# Autodesk Inventor assembly: 2026 Tiger Burn Head (UPDATED 2x4 TRUE) Model
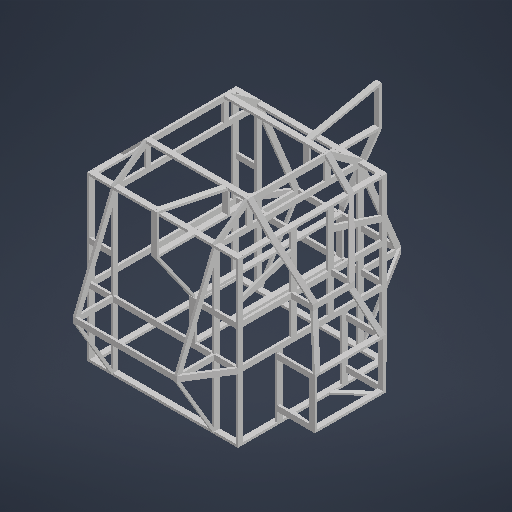
[picture p0: Inventor's stored thumbnail of the model, 512x512]
Saved by Autodesk Inventor 2027 (Build 310192000, 192)
## iProperties
Created: 2026-10-16
Part Number: 2026 Tiger Burn Head (UPDATED 2x4 TRUE) Model
Document SubType Name: Assembly
Designer: lucas
Author: lucas
## Documents named in this file (81)
- C:\Users\lucas\OneDrive\Documents\Inventor\Tiger Burn Head Frame 2026\2026 Tiger Burn Head (UPDATED 2x4 TRUE) Model.iam
- C:\Users\lucas\OneDrive\Documents\Inventor\Tiger Burn Head Frame 2026\2x4x96.ipt
- C:\Users\lucas\OneDrive\Documents\Inventor\Tiger Burn Head Frame 2026\2x4x88.ipt
- C:\Users\lucas\OneDrive\Documents\Inventor\Tiger Burn Head Frame 2026\2x4x101.ipt
- C:\Users\lucas\OneDrive\Documents\Inventor\Tiger Burn Head Frame 2026\2x4x39.ipt
- C:\Users\lucas\OneDrive\Documents\Inventor\Tiger Burn Head Frame 2026\2x4x101_MIR2.ipt
- C:\Users\lucas\OneDrive\Documents\Inventor\Tiger Burn Head Frame 2026\2x4x101_MIR3.ipt
- C:\Users\lucas\OneDrive\Documents\Inventor\Tiger Burn Head Frame 2026\2x4x101_MIR2_MIR.ipt
- C:\Users\lucas\OneDrive\Documents\Inventor\Tiger Burn Head Frame 2026\2x4x88_MIR2.ipt
- C:\Users\lucas\OneDrive\Documents\Inventor\Tiger Burn Head Frame 2026\2x4x13.ipt
- C:\Users\lucas\OneDrive\Documents\Inventor\Tiger Burn Head Frame 2026\2x4x13_MIR6.ipt
- C:\Users\lucas\OneDrive\Documents\Inventor\Tiger Burn Head Frame 2026\2x4x13_MIR7.ipt
- C:\Users\lucas\OneDrive\Documents\Inventor\Tiger Burn Head Frame 2026\2x4x13_MIR6_MIR.ipt
- C:\Users\lucas\OneDrive\Documents\Inventor\Tiger Burn Head Frame 2026\2x4x13_MIR8.ipt
- C:\Users\lucas\OneDrive\Documents\Inventor\Tiger Burn Head Frame 2026\2x4x13_MIR9.ipt
- C:\Users\lucas\OneDrive\Documents\Inventor\Tiger Burn Head Frame 2026\2x4x13_MIR8_MIR.ipt
- C:\Users\lucas\OneDrive\Documents\Inventor\Tiger Burn Head Frame 2026\2x4x15_MIR4.ipt
- C:\Users\lucas\OneDrive\Documents\Inventor\Tiger Burn Head Frame 2026\2x4x62.ipt
- C:\Users\lucas\OneDrive\Documents\Inventor\Tiger Burn Head Frame 2026\2x4x15_MIR6.ipt
- C:\Users\lucas\OneDrive\Documents\Inventor\Tiger Burn Head Frame 2026\2x4x62_MIR.ipt
- C:\Users\lucas\OneDrive\Documents\Inventor\Tiger Burn Head Frame 2026\2x4x44_MIR1.ipt
- C:\Users\lucas\OneDrive\Documents\Inventor\Tiger Burn Head Frame 2026\Top of Head Diagonals 2.ipt
- C:\Users\lucas\OneDrive\Documents\Inventor\Tiger Burn Head Frame 2026\Top of Head Diagonals 2_MIR.ipt
- C:\Users\lucas\OneDrive\Documents\Inventor\Tiger Burn Head Frame 2026\Top of Diagonals 1_MIR.ipt
- C:\Users\lucas\OneDrive\Documents\Inventor\Tiger Burn Head Frame 2026\Top of Diagonals 1_MIR_MIR.ipt
- C:\Users\lucas\OneDrive\Documents\Inventor\Tiger Burn Head Frame 2026\2x4x13_MIR10.ipt
- C:\Users\lucas\OneDrive\Documents\Inventor\Tiger Burn Head Frame 2026\2x4x24(with a cut).ipt
- C:\Users\lucas\OneDrive\Documents\Inventor\Tiger Burn Head Frame 2026\2x4x24(with a cut)_MIR2.ipt
- C:\Users\lucas\OneDrive\Documents\Inventor\Tiger Burn Head Frame 2026\Top side diagonals.ipt
- C:\Users\lucas\OneDrive\Documents\Inventor\Tiger Burn Head Frame 2026\Bottom side diagonals.ipt
- C:\Users\lucas\OneDrive\Documents\Inventor\Tiger Burn Head Frame 2026\Top side diagonals_MIR.ipt
- C:\Users\lucas\OneDrive\Documents\Inventor\Tiger Burn Head Frame 2026\Bottom side diagonals_MIR.ipt
- C:\Users\lucas\OneDrive\Documents\Inventor\Tiger Burn Head Frame 2026\2x4x62_MIR1.ipt
- C:\Users\lucas\OneDrive\Documents\Inventor\Tiger Burn Head Frame 2026\2x4x21.ipt
- C:\Users\lucas\OneDrive\Documents\Inventor\Tiger Burn Head Frame 2026\2x4x24.ipt
- C:\Users\lucas\OneDrive\Documents\Inventor\Tiger Burn Head Frame 2026\2x4x24_MIR2.ipt
- C:\Users\lucas\OneDrive\Documents\Inventor\Tiger Burn Head Frame 2026\2x4x24(with a cut)_MIR4.ipt
- C:\Users\lucas\OneDrive\Documents\Inventor\Tiger Burn Head Frame 2026\2x4x24(with a cut)_MIR2_MIR1.ipt
- C:\Users\lucas\OneDrive\Documents\Inventor\Tiger Burn Head Frame 2026\Top side diagonals_MIR2.ipt
- C:\Users\lucas\OneDrive\Documents\Inventor\Tiger Burn Head Frame 2026\Bottom side diagonals_MIR2.ipt
- C:\Users\lucas\OneDrive\Documents\Inventor\Tiger Burn Head Frame 2026\Top side diagonals_MIR_MIR1.ipt
- C:\Users\lucas\OneDrive\Documents\Inventor\Tiger Burn Head Frame 2026\Bottom side diagonals_MIR_MIR1.ipt
- C:\Users\lucas\OneDrive\Documents\Inventor\Tiger Burn Head Frame 2026\2x4x62_MIR2.ipt
- C:\Users\lucas\OneDrive\Documents\Inventor\Tiger Burn Head Frame 2026\2x4x26.ipt
- C:\Users\lucas\OneDrive\Documents\Inventor\Tiger Burn Head Frame 2026\2x4x26_MIR1.ipt
- C:\Users\lucas\OneDrive\Documents\Inventor\Tiger Burn Head Frame 2026\2x4x38.ipt
- C:\Users\lucas\OneDrive\Documents\Inventor\Tiger Burn Head Frame 2026\2x4x34.ipt
- C:\Users\lucas\OneDrive\Documents\Inventor\Tiger Burn Head Frame 2026\2x4x34_MIR.ipt
- C:\Users\lucas\OneDrive\Documents\Inventor\Tiger Burn Head Frame 2026\Eyelid.ipt
- C:\Users\lucas\OneDrive\Documents\Inventor\Tiger Burn Head Frame 2026\Eyelid_MIR.ipt
- C:\Users\lucas\OneDrive\Documents\Inventor\Tiger Burn Head Frame 2026\2x4x13_MIR11.ipt
- C:\Users\lucas\OneDrive\Documents\Inventor\Tiger Burn Head Frame 2026\Upper Nose Diagonals.ipt
- C:\Users\lucas\OneDrive\Documents\Inventor\Tiger Burn Head Frame 2026\2x4x15_MIR4_MIR.ipt
- C:\Users\lucas\OneDrive\Documents\Inventor\Tiger Burn Head Frame 2026\2x4x15_MIR6_MIR.ipt
- C:\Users\lucas\OneDrive\Documents\Inventor\Tiger Burn Head Frame 2026\2x4x62_MIR_MIR.ipt
- C:\Users\lucas\OneDrive\Documents\Inventor\Tiger Burn Head Frame 2026\Top of Head Diagonals 2_MIR2.ipt
- C:\Users\lucas\OneDrive\Documents\Inventor\Tiger Burn Head Frame 2026\Top of Head Diagonals 2_MIR_MIR1.ipt
- C:\Users\lucas\OneDrive\Documents\Inventor\Tiger Burn Head Frame 2026\Top of Diagonals 1_MIR_MIR1.ipt
- C:\Users\lucas\OneDrive\Documents\Inventor\Tiger Burn Head Frame 2026\Top of Diagonals 1_MIR_MIR_MIR.ipt
- C:\Users\lucas\OneDrive\Documents\Inventor\Tiger Burn Head Frame 2026\2x4x13_MIR10_MIR.ipt
- C:\Users\lucas\OneDrive\Documents\Inventor\Tiger Burn Head Frame 2026\Upper Nose Diagonals_MIR.ipt
- C:\Users\lucas\OneDrive\Documents\Inventor\Tiger Burn Head Frame 2026\Lower Nose Diagonal.ipt
- C:\Users\lucas\OneDrive\Documents\Inventor\Tiger Burn Head Frame 2026\Lower Nose Diagonal_MIR.ipt
- C:\Users\lucas\OneDrive\Documents\Inventor\Tiger Burn Head Frame 2026\Lower Jaw Diagonals.ipt
- C:\Users\lucas\OneDrive\Documents\Inventor\Tiger Burn Head Frame 2026\Lower Jaw Diagonals_MIR.ipt
- C:\Users\lucas\OneDrive\Documents\Inventor\Tiger Burn Head Frame 2026\2x4x26.2.ipt
- C:\Users\lucas\OneDrive\Documents\Inventor\Tiger Burn Head Frame 2026\2x4x26.2_MIR.ipt
- C:\Users\lucas\OneDrive\Documents\Inventor\Tiger Burn Head Frame 2026\2x4x90.ipt
- C:\Users\lucas\OneDrive\Documents\Inventor\Tiger Burn Head Frame 2026\Side Connectors.2.ipt
- C:\Users\lucas\OneDrive\Documents\Inventor\Tiger Burn Head Frame 2026\Side Connectors.2_MIR.ipt
- C:\Users\lucas\OneDrive\Documents\Inventor\Tiger Burn Head Frame 2026\Side Connectors.2_MIR1.ipt
- C:\Users\lucas\OneDrive\Documents\Inventor\Tiger Burn Head Frame 2026\Side Connectors.2_MIR_MIR.ipt
- C:\Users\lucas\OneDrive\Documents\Inventor\Tiger Burn Head Frame 2026\2x4x(Rename).ipt
- C:\Users\lucas\OneDrive\Documents\Inventor\Tiger Burn Head Frame 2026\2x4x(Rename)_MIR1.ipt
- C:\Users\lucas\OneDrive\Documents\Inventor\Tiger Burn Head Frame 2026\Lower Ear Diagonals.ipt
- C:\Users\lucas\OneDrive\Documents\Inventor\Tiger Burn Head Frame 2026\2x4x24_MIR3.ipt
- C:\Users\lucas\OneDrive\Documents\Inventor\Tiger Burn Head Frame 2026\Lower Ear Diagonals_MIR.ipt
- C:\Users\lucas\OneDrive\Documents\Inventor\Tiger Burn Head Frame 2026\2x4x30_MIR.ipt
- C:\Users\lucas\OneDrive\Documents\Inventor\Tiger Burn Head Frame 2026\Upper Ear Diagonals.ipt
- C:\Users\lucas\OneDrive\Documents\Inventor\Tiger Burn Head Frame 2026\2x4x30_MIR_MIR.ipt
- C:\Users\lucas\OneDrive\Documents\Inventor\Tiger Burn Head Frame 2026\Upper Ear Diagonals_MIR.ipt
## Components (107 placed, 81 different names)
1. 2x4x96:1 — Mate:1, Flush:1, Flush:2, Flush:3, Mate:2, Flush:4, Mate:4, Flush:7, Flush:8, Flush:9, Flush:10, Mate:61, Mate:62
2. 2x4x96:2 — Mate:3, Flush:5, Flush:6, Mate:6, Mate:7, Flush:11, Flush:12, Flush:13, Mate:8
3. 2x4x88:1 — Mate:1, Flush:1, Flush:2, Mate:3, Flush:5, Flush:6, Mate:5, Flush:14, Mate:12, Mate:13, Mate:19, Mate:49, Flush:115
4. 2x4x88:2 — Flush:3, Mate:2, Flush:4, Mate:17
5. 2x4x101:1 — Mate:4, Flush:7, Flush:8, Flush:18, Mate:18, Flush:38, Flush:39
6. 2x4x101:2 — Mate:7, Flush:13, Flush:14, Mate:9, Mate:10, Mate:11, Flush:15, Flush:17, Flush:19, Mate:20, Flush:20, Flush:21, Mate:21, Mate:25, Mate:30, Flush:33, Mate:31, Flush:35
7. 2x4x101:3 — Mate:6, Flush:11, Flush:12
8. 2x4x101:4 — Flush:9, Flush:10, Mate:5, Flush:16, Mate:16, Mate:22, Flush:22, Flush:23, Mate:47, Mate:60, Mate:65, Flush:101, Flush:102
9. 2x4x88:3 — Mate:11, Flush:15, Mate:12, Mate:14, Flush:32, Flush:71, Flush:72, Mate:51, Flush:89
10. 2x4x39:1 — Mate:13, Flush:16, Mate:15, Mate:16, Flush:77, Flush:94
11. 2x4x39:2 — Mate:14, Flush:17, Mate:15, Mate:50, Flush:75, Mate:52, Flush:76
12. 2x4x88:4 — Mate:19, Flush:19, Mate:20, Flush:34, Flush:73, Mate:45, Flush:74, Flush:99, Flush:100, Mate:69, Flush:104, Flush:125
13. 2x4x88:5 — Mate:17, Flush:18, Mate:18
14. 2x4x96:3 — Flush:20, Flush:21, Mate:21, Mate:23, Flush:24, Flush:25, Mate:24, Flush:26, Flush:27, Mate:26, Flush:28, Flush:30, Mate:27, Mate:29, Flush:31, Mate:78, Flush:126
15. 2x4x96:4 — Mate:22, Flush:22, Flush:23, Flush:36, Flush:37, Flush:52
16. 2x4x88:6 — Mate:23, Flush:24, Flush:25, Mate:28, Flush:109
17. 2x4x88:7 — Mate:24, Flush:26, Flush:27
18. 2x4x101:5 — Mate:25, Mate:26, Flush:28, Flush:29, Flush:61, Flush:62, Flush:63, Flush:64, Mate:42, Mate:48, Mate:74
19. 2x4x101_MIR2:1 — Mate:41, Flush:59
20. 2x4x101_MIR3:1 — Flush:37, Flush:40, Flush:41, Mate:62, Flush:90, Flush:91, Mate:64, Mate:65
21. 2x4x101_MIR2_MIR:1 — Flush:36, Mate:61, Mate:63, Mate:64
22. 2x4x88:8 — Flush:29, Flush:30, Mate:27
23. 2x4x88:9 — Mate:28, Mate:29, Flush:31, Flush:58
24. 2x4x88_MIR2:1
25. 2x4x13:1 — Mate:30, Flush:32, Flush:33, Flush:65, Flush:66
26. 2x4x13_MIR6:1 — Flush:60
27. 2x4x13_MIR7:1 — Flush:40, Flush:79, Mate:60, Flush:89, Flush:90
28. 2x4x13_MIR6_MIR:1 — Flush:38, Flush:80, Flush:88
29. 2x4x13:2 — Mate:31, Flush:34, Flush:35, Flush:134
30. 2x4x13_MIR8:1 — Flush:134, Flush:135
31. 2x4x13_MIR9:1 — Flush:41, Flush:125
32. 2x4x13_MIR8_MIR:1 — Flush:39, Flush:135
33. 2x4x15_MIR4:1
34. 2x4x15_MIR6:1 — Flush:53
35. 2x4x62_MIR:1
36. 2x4x46_MIR1:1
37. 2x4x46_MIR1:2
38. Top of Head Diagonals 2:1 — Flush:52, Flush:53
39. Top of Head Diagonals 2_MIR:1
40. Top of Diagonals 1_MIR:1
41. Top of Diagonals 1_MIR_MIR:1
42. 2x4x13_MIR10:1 — Flush:58
43. 2x4x24(with a cut):1 — Mate:41, Flush:59, Flush:60
44. 2x4x24(with a cut)_MIR2:1 — Flush:122, Flush:123
45. Top side diagonals:1 — Flush:61, Flush:62
46. Bottom side diagonals:1 — Flush:63, Flush:64
47. Top side diagonals_MIR:1
48. Bottom side diagonals_MIR:1
49. 2x4x62:2 — Mate:42, Flush:65, Flush:66, Mate:43, Flush:67, Flush:68, Flush:116, Flush:117
50. 2x4x62:3 — Mate:43, Flush:67, Flush:68
51. 2x4x62_MIR1:1 — Flush:79, Flush:80, Flush:88, Flush:91, Mate:63, Mate:76, Flush:121
52. 2x4x21:1 — Flush:71, Flush:72, Flush:73, Mate:46, Mate:48
53. 2x4x21:2 — Mate:45, Flush:74, Mate:46, Mate:47
54. 2x4x24:1 — Mate:49, Mate:50, Flush:75, Mate:68, Flush:97, Flush:98, Flush:113, Flush:114
55. 2x4x24:2 — Mate:51, Mate:52, Flush:76, Symmetry:1, Mate:66, Flush:92, Flush:93, Mate:67, Flush:95, Flush:96, Flush:110, Flush:111
56. 2x4x24_MIR2:1 — Flush:94
57. 2x4x24_MIR2:2 — Flush:77, Symmetry:1
58. 2x4x24(with a cut)_MIR4:1
59. 2x4x24(with a cut)_MIR2_MIR1:1
60. Top side diagonals_MIR2:1
61. Bottom side diagonals_MIR2:1
62. Top side diagonals_MIR_MIR1:1
63. Bottom side diagonals_MIR_MIR1:1
64. 2x4x62_MIR2:1
65. 2x4x25:1 — Mate:66, Flush:92, Flush:93
66. 2x4x25_MIR1:1
67. 2x4x42:1 — Mate:67, Flush:95, Flush:96
68. 2x4x38:2 — Mate:68, Flush:97, Flush:98
69. 2x4x34:1 — Flush:99, Flush:100
70. 2x4x34_MIR:1 — Flush:103
71. Eyelid:1 — Flush:101, Flush:102
72. Eyelid_MIR:1
73. 2x4x13:4 — Mate:69, Flush:103, Flush:104, Mate:71, Flush:107, Flush:108
74. 2x4x13_MIR11:1 — Mate:71, Mate:72, Flush:105, Flush:106, Flush:112
75. 2x4x24:3 — Mate:72, Flush:105, Flush:106
76. Upper Nose Diagonals:1 — Flush:107, Flush:108, Flush:109
77. 2x4x15_MIR4_MIR:1
78. 2x4x15_MIR6_MIR:1 — Mate:73
79. 2x4x62_MIR_MIR:1
80. Top of Head Diagonals 2_MIR2:1 — Mate:73
81. Top of Head Diagonals 2_MIR_MIR1:1
82. Top of Diagonals 1_MIR_MIR1:1
83. Top of Diagonals 1_MIR_MIR_MIR:1
84. 2x4x13_MIR10_MIR:1
85. Upper Nose Diagonals_MIR:1
86. Lower Nose Diagonal:1 — Flush:110, Flush:111, Flush:112
87. Lower Nose Diagonal_MIR:1
88. Lower Jaw Diagonals:1 — Flush:113, Flush:114, Flush:115
89. Lower Jaw Diagonals_MIR:1
90. 2x4x26.2:1 — Flush:116, Flush:117, Mate:74, Mate:77, Flush:124, Flush:127, Flush:128, Flush:129
91. 2x4x26.2_MIR:1 — Mate:75, Flush:118, Flush:119, Flush:120
92. 2x4x92:1 — Mate:75, Flush:118, Flush:119
93. 2x4x92:2 — Mate:76, Flush:120, Flush:121
94. Side Connectors.2:1 — Flush:122, Flush:123
95. Side Connectors.2_MIR:1
96. Side Connectors.2_MIR1:1
97. Side Connectors.2_MIR_MIR:1
98. 2x4x11:1 — Mate:77, Flush:124
99. 2x4x(Rename)_MIR1:1
100. 2x4x24:4 — Mate:78, Flush:126, Flush:127, Mate:79, Flush:130, Flush:131
101. Lower Ear Diagonals:1 — Flush:128, Flush:129
102. 2x4x24_MIR3:1
103. Lower Ear Diagonals_MIR:1
104. 2x4x30_MIR:1 — Mate:79, Flush:130, Flush:131, Flush:132, Flush:133
105. Upper Ear Diagonals:1 — Flush:132, Flush:133
106. 2x4x30_MIR_MIR:1 — Mate:80, Mate:81
107. Upper Ear Diagonals_MIR:1 — Mate:80, Mate:81
## Relationships (175: Flush 111, Mate 63, Symmetry 1)
- Mate:1: 2x4x96:1 ↔ 2x4x88:1
- Flush:1: 2x4x96:1 ↔ 2x4x88:1
- Flush:2: 2x4x96:1 ↔ 2x4x88:1
- Flush:3: 2x4x96:1 ↔ 2x4x88:2
- Mate:2: 2x4x96:1 ↔ 2x4x88:2
- Flush:4: 2x4x96:1 ↔ 2x4x88:2
- Mate:3: 2x4x96:2 ↔ 2x4x88:1
- Flush:5: 2x4x96:2 ↔ 2x4x88:1
- Flush:6: 2x4x96:2 ↔ 2x4x88:1
- Mate:4: 2x4x96:1 ↔ 2x4x101:1
- Flush:7: 2x4x96:1 ↔ 2x4x101:1
- Flush:8: 2x4x96:1 ↔ 2x4x101:1
- Flush:9: 2x4x96:1 ↔ 2x4x101:4
- Flush:10: 2x4x96:1 ↔ 2x4x101:4
- Mate:5: 2x4x88:1 ↔ 2x4x101:4
- Mate:6: 2x4x96:2 ↔ 2x4x101:3
- Mate:7: 2x4x96:2 ↔ 2x4x101:2
- Flush:11: 2x4x96:2 ↔ 2x4x101:3
- Flush:12: 2x4x96:2 ↔ 2x4x101:3
- Flush:13: 2x4x96:2 ↔ 2x4x101:2
- Flush:14: 2x4x88:1 ↔ 2x4x101:2
- Mate:8: 2x4x96:2
- Mate:9 (1219.2 mm): 2x4x101:2
- Mate:10 (-1219.2 mm): 2x4x101:2
- Mate:11: 2x4x101:2 ↔ 2x4x88:3
- Flush:15: 2x4x101:2 ↔ 2x4x88:3
- Mate:12 (990.6 mm): 2x4x88:1 ↔ 2x4x88:3
- Mate:13: 2x4x88:1 ↔ 2x4x39:1
- Flush:16: 2x4x101:4 ↔ 2x4x39:1
- Mate:14: 2x4x88:3 ↔ 2x4x39:2
- Flush:17: 2x4x101:2 ↔ 2x4x39:2
- Mate:15 (965.2 mm): 2x4x39:1 ↔ 2x4x39:2
- Mate:16 (546.1 mm): 2x4x101:4 ↔ 2x4x39:1
- Mate:17 (990.6 mm): 2x4x88:2 ↔ 2x4x88:5
- Flush:18: 2x4x101:1 ↔ 2x4x88:5
- Mate:18: 2x4x101:1 ↔ 2x4x88:5
- Mate:19 (1651 mm): 2x4x88:1 ↔ 2x4x88:4
- Flush:19: 2x4x101:2 ↔ 2x4x88:4
- Mate:20: 2x4x101:2 ↔ 2x4x88:4
- Flush:20: 2x4x101:2 ↔ 2x4x96:3
- Flush:21: 2x4x101:2 ↔ 2x4x96:3
- Mate:21: 2x4x101:2 ↔ 2x4x96:3
- Mate:22: 2x4x101:4 ↔ 2x4x96:4
- Flush:22: 2x4x101:4 ↔ 2x4x96:4
- Flush:23: 2x4x101:4 ↔ 2x4x96:4
- Mate:23: 2x4x96:3 ↔ 2x4x88:6
- Flush:24: 2x4x96:3 ↔ 2x4x88:6
- Flush:25: 2x4x96:3 ↔ 2x4x88:6
- Mate:24: 2x4x96:3 ↔ 2x4x88:7
- Flush:26: 2x4x96:3 ↔ 2x4x88:7
- Flush:27: 2x4x96:3 ↔ 2x4x88:7
- Mate:25 (342.9 mm): 2x4x101:2 ↔ 2x4x101:5
- Mate:26: 2x4x96:3 ↔ 2x4x101:5
- Flush:28: 2x4x96:3 ↔ 2x4x101:5
- Flush:29: 2x4x101:5 ↔ 2x4x88:8
- Flush:30: 2x4x96:3 ↔ 2x4x88:8
- Mate:27: 2x4x96:3 ↔ 2x4x88:8
- Mate:28 (609.6 mm): 2x4x88:6 ↔ 2x4x88:9
- Mate:29: 2x4x96:3 ↔ 2x4x88:9
- Flush:31: 2x4x96:3 ↔ 2x4x88:9
- Mate:30: 2x4x101:2 ↔ 2x4x13:1
- Flush:32: 2x4x88:3 ↔ 2x4x13:1
- Flush:33: 2x4x101:2 ↔ 2x4x13:1
- Mate:31: 2x4x101:2 ↔ 2x4x13:2
- Flush:34: 2x4x88:4 ↔ 2x4x13:2
- Flush:35: 2x4x101:2 ↔ 2x4x13:2
- Flush:36: 2x4x96:4 ↔ 2x4x101_MIR2_MIR:1
- Flush:37: 2x4x96:4 ↔ 2x4x101_MIR3:1
- Flush:38: 2x4x101:1 ↔ 2x4x13_MIR6_MIR:1
- Flush:39: 2x4x101:1 ↔ 2x4x13_MIR8_MIR:1
- Flush:40: 2x4x101_MIR3:1 ↔ 2x4x13_MIR7:1
- Flush:41: 2x4x101_MIR3:1 ↔ 2x4x13_MIR9:1
- Flush:52: 2x4x96:4 ↔ Top of Head Diagonals 2:1
- Flush:53: 2x4x15_MIR6:1 ↔ Top of Head Diagonals 2:1
- Flush:58: 2x4x88:9 ↔ 2x4x13_MIR10:1
- Mate:41: 2x4x101_MIR2:1 ↔ 2x4x24(with a cut):1
- Flush:59: 2x4x101_MIR2:1 ↔ 2x4x24(with a cut):1
- Flush:60: 2x4x13_MIR6:1 ↔ 2x4x24(with a cut):1
- Flush:61: 2x4x101:5 ↔ Top side diagonals:1
- Flush:62: 2x4x101:5 ↔ Top side diagonals:1
- Flush:63: 2x4x101:5 ↔ Bottom side diagonals:1
- Flush:64: 2x4x101:5 ↔ Bottom side diagonals:1
- Mate:42: 2x4x101:5 ↔ 2x4x62:2
- Flush:65: 2x4x13:1 ↔ 2x4x62:2
- Flush:66: 2x4x13:1 ↔ 2x4x62:2
- Mate:43 (571.5 mm): 2x4x62:2 ↔ 2x4x62:3
- Flush:67: 2x4x62:2 ↔ 2x4x62:3
- Flush:68: 2x4x62:2 ↔ 2x4x62:3
- Flush:71: 2x4x88:3 ↔ 2x4x21:1
- Flush:72: 2x4x88:3 ↔ 2x4x21:1
- Flush:73: 2x4x88:4 ↔ 2x4x21:1
- Mate:45: 2x4x88:4 ↔ 2x4x21:2
- Flush:74: 2x4x88:4 ↔ 2x4x21:2
- Mate:46 (508 mm): 2x4x21:1 ↔ 2x4x21:2
- Mate:47 (774.7 mm): 2x4x101:4 ↔ 2x4x21:2
- Mate:48 (774.7 mm): 2x4x101:5 ↔ 2x4x21:1
- Mate:49 (-279.4 mm): 2x4x88:1 ↔ 2x4x24:1
- Mate:50: 2x4x39:2 ↔ 2x4x24:1
- Flush:75: 2x4x39:2 ↔ 2x4x24:1
- Mate:51 (-203.2 mm): 2x4x88:3 ↔ 2x4x24:2
- Mate:52: 2x4x39:2 ↔ 2x4x24:2
- Flush:76: 2x4x39:2 ↔ 2x4x24:2
- Flush:77: 2x4x39:1 ↔ 2x4x24_MIR2:2
- Flush:79: 2x4x13_MIR7:1 ↔ 2x4x62_MIR1:1
- Flush:80: 2x4x13_MIR6_MIR:1 ↔ 2x4x62_MIR1:1
- Flush:88: 2x4x13_MIR6_MIR:1 ↔ 2x4x62_MIR1:1
- Mate:60: 2x4x101:4 ↔ 2x4x13_MIR7:1
- Mate:61: 2x4x96:1 ↔ 2x4x101_MIR2_MIR:1
- Symmetry:1: 2x4x24:2 ↔ 2x4x24_MIR2:2
- Mate:62: 2x4x96:1 ↔ 2x4x101_MIR3:1
- Flush:89: 2x4x88:3 ↔ 2x4x13_MIR7:1
- Flush:90: 2x4x101_MIR3:1 ↔ 2x4x13_MIR7:1
- Flush:91: 2x4x101_MIR3:1 ↔ 2x4x62_MIR1:1
- Mate:63: 2x4x101_MIR2_MIR:1 ↔ 2x4x62_MIR1:1
- Mate:64 (1600.2 mm): 2x4x101_MIR3:1 ↔ 2x4x101_MIR2_MIR:1
- Mate:65 (342.9 mm): 2x4x101:4 ↔ 2x4x101_MIR3:1
- Mate:66: 2x4x24:2 ↔ 2x4x25:1
- Flush:92: 2x4x24:2 ↔ 2x4x25:1
- Flush:93: 2x4x24:2 ↔ 2x4x25:1
- Flush:94: 2x4x39:1 ↔ 2x4x24_MIR2:1
- Mate:67: 2x4x24:2 ↔ 2x4x42:1
- Flush:95: 2x4x24:2 ↔ 2x4x42:1
- Flush:96: 2x4x24:2 ↔ 2x4x42:1
- Mate:68: 2x4x24:1 ↔ 2x4x38:2
- Flush:97: 2x4x24:1 ↔ 2x4x38:2
- Flush:98: 2x4x24:1 ↔ 2x4x38:2
- Flush:99: 2x4x88:4 ↔ 2x4x34:1
- Flush:100: 2x4x88:4 ↔ 2x4x34:1
- Flush:101: 2x4x101:4 ↔ Eyelid:1
- Flush:102: 2x4x101:4 ↔ Eyelid:1
- Mate:69: 2x4x88:4 ↔ 2x4x13:4
- Flush:103: 2x4x34_MIR:1 ↔ 2x4x13:4
- Flush:104: 2x4x88:4 ↔ 2x4x13:4
- Mate:71 (609.6 mm): 2x4x13:4 ↔ 2x4x13_MIR11:1
- Mate:72: 2x4x13_MIR11:1 ↔ 2x4x24:3
- Flush:105: 2x4x13_MIR11:1 ↔ 2x4x24:3
- Flush:106: 2x4x13_MIR11:1 ↔ 2x4x24:3
- Flush:107: 2x4x13:4 ↔ Upper Nose Diagonals:1
- Flush:108: 2x4x13:4 ↔ Upper Nose Diagonals:1
- Flush:109: 2x4x88:6 ↔ Upper Nose Diagonals:1
- Mate:73: 2x4x15_MIR6_MIR:1 ↔ Top of Head Diagonals 2_MIR2:1
- Flush:110: 2x4x24:2 ↔ Lower Nose Diagonal:1
- Flush:111: 2x4x24:2 ↔ Lower Nose Diagonal:1
- Flush:112: 2x4x13_MIR11:1 ↔ Lower Nose Diagonal:1
- Flush:113: 2x4x24:1 ↔ Lower Jaw Diagonals:1
- Flush:114: 2x4x24:1 ↔ Lower Jaw Diagonals:1
- Flush:115: 2x4x88:1 ↔ Lower Jaw Diagonals:1
- Flush:116: 2x4x62:2 ↔ 2x4x26.2:1
- Flush:117: 2x4x62:2 ↔ 2x4x26.2:1
- Mate:74 (279.4 mm): 2x4x101:5 ↔ 2x4x26.2:1
- Mate:75: 2x4x26.2_MIR:1 ↔ 2x4x92:1
- Flush:118: 2x4x26.2_MIR:1 ↔ 2x4x92:1
- Flush:119: 2x4x26.2_MIR:1 ↔ 2x4x92:1
- Mate:76: 2x4x62_MIR1:1 ↔ 2x4x92:2
- Flush:120: 2x4x26.2_MIR:1 ↔ 2x4x92:2
- Flush:121: 2x4x62_MIR1:1 ↔ 2x4x92:2
- Flush:122: 2x4x24(with a cut)_MIR2:1 ↔ Side Connectors.2:1
- Flush:123: 2x4x24(with a cut)_MIR2:1 ↔ Side Connectors.2:1
- Mate:77: 2x4x26.2:1 ↔ 2x4x11:1
- Flush:124: 2x4x26.2:1 ↔ 2x4x11:1
- Flush:125: 2x4x88:4 ↔ 2x4x13_MIR9:1
- Mate:78: 2x4x96:3 ↔ 2x4x24:4
- Flush:126: 2x4x96:3 ↔ 2x4x24:4
- Flush:127: 2x4x26.2:1 ↔ 2x4x24:4
- Flush:128: 2x4x26.2:1 ↔ Lower Ear Diagonals:1
- Flush:129: 2x4x26.2:1 ↔ Lower Ear Diagonals:1
- Mate:79: 2x4x24:4 ↔ 2x4x30_MIR:1
- Flush:130: 2x4x24:4 ↔ 2x4x30_MIR:1
- Flush:131: 2x4x24:4 ↔ 2x4x30_MIR:1
- Flush:132: 2x4x30_MIR:1 ↔ Upper Ear Diagonals:1
- Flush:133: 2x4x30_MIR:1 ↔ Upper Ear Diagonals:1
- Mate:80: 2x4x30_MIR_MIR:1 ↔ Upper Ear Diagonals_MIR:1
- Mate:81: 2x4x30_MIR_MIR:1 ↔ Upper Ear Diagonals_MIR:1
- Flush:134: 2x4x13:2 ↔ 2x4x13_MIR8:1
- Flush:135: 2x4x13_MIR8:1 ↔ 2x4x13_MIR8_MIR:1
